# Autodesk Inventor assembly: ASSEMBLY_DUT_Ant_Rotator_REVB
(part 2 of 5)
199. COTS_BOSSARD_1400444_M6_Nylon_Nut:62 — Mate:495, Mate:498, Angle:62
200. COTS_BOSSARD_1400444_M6_Nylon_Nut:61 — Mate:494, Mate:499, Angle:61
201. COTS_BOSSARD_1400444_M6_Nylon_Nut:60 — Mate:496, Mate:497, Angle:63
202. COTS_DREMEC_8G206M6X50_M6x50_Nylon_Screw:62 — Mate:488, Mate:493, Mate:497
203. COTS_DREMEC_8G206M6X50_M6x50_Nylon_Screw:61 — Mate:489, Mate:491, Mate:499
204. COTS_DREMEC_8G206M6X50_M6x50_Nylon_Screw:60 — Mate:490, Mate:492, Mate:498
205. COTS_BOSSARD_1400444_M6_Nylon_Nut:59 — Mate:477, Mate:479, Angle:60
206. COTS_BOSSARD_1400444_M6_Nylon_Nut:58 — Mate:478, Mate:480, Angle:59
207. COTS_BOSSARD_1400444_M6_Nylon_Nut:57 — Mate:476, Mate:484, Angle:58
208. COTS_BOSSARD_1400444_M6_Nylon_Nut:56 — Mate:475, Mate:483, Angle:57
209. COTS_BOSSARD_1400444_M6_Nylon_Nut:55 — Mate:473, Mate:481, Angle:55
210. COTS_BOSSARD_1400444_M6_Nylon_Nut:54 — Mate:474, Mate:482, Angle:56
211. COTS_DREMEC_8G206M6X50_M6x50_Nylon_Screw:59 — Mate:465, Mate:470, Mate:484
212. COTS_DREMEC_8G206M6X50_M6x50_Nylon_Screw:58 — Mate:466, Mate:469, Mate:483
213. COTS_DREMEC_8G206M6X50_M6x50_Nylon_Screw:57 — Mate:464, Mate:471, Mate:480
214. COTS_DREMEC_8G206M6X50_M6x50_Nylon_Screw:56 — Mate:463, Mate:468, Mate:482
215. COTS_DREMEC_8G206M6X50_M6x50_Nylon_Screw:55 — Mate:461, Mate:472, Mate:479
216. COTS_DREMEC_8G206M6X50_M6x50_Nylon_Screw:54 — Mate:462, Mate:467, Mate:481
217. COTS_BOSSARD_1400444_M6_Nylon_Nut:53 — Mate:439, Mate:459, Angle:45
218. COTS_BOSSARD_1400444_M6_Nylon_Nut:52 — Mate:440, Mate:457, Angle:46
219. COTS_BOSSARD_1400444_M6_Nylon_Nut:51 — Mate:445, Mate:450
220. COTS_BOSSARD_1400444_M6_Nylon_Nut:50 — Mate:438, Mate:454, Angle:48
221. COTS_BOSSARD_1400444_M6_Nylon_Nut:49 — Mate:441, Mate:455, Angle:49
222. COTS_BOSSARD_1400444_M6_Nylon_Nut:48 — Mate:447, Mate:448, Angle:51
223. COTS_BOSSARD_1400444_M6_Nylon_Nut:47 — Mate:437, Mate:456, Angle:47
224. COTS_BOSSARD_1400444_M6_Nylon_Nut:46 — Mate:442, Mate:451
225. COTS_BOSSARD_1400444_M6_Nylon_Nut:45 — Mate:446, Mate:449, Angle:53
226. COTS_BOSSARD_1400444_M6_Nylon_Nut:44 — Mate:436, Mate:458, Angle:44
227. COTS_BOSSARD_1400444_M6_Nylon_Nut:43 — Mate:443, Mate:452, Angle:52
228. COTS_BOSSARD_1400444_M6_Nylon_Nut:42 — Mate:444, Mate:453, Angle:50
229. COTS_DREMEC_8G206M6X50_M6x50_Nylon_Screw:53 — Mate:423, Mate:426, Mate:456
230. COTS_DREMEC_8G206M6X50_M6x50_Nylon_Screw:52 — Mate:422, Mate:424, Mate:454
231. COTS_DREMEC_8G206M6X50_M6x50_Nylon_Screw:51 — Mate:421, Mate:429, Mate:459
232. COTS_DREMEC_8G206M6X50_M6x50_Nylon_Screw:50 — Mate:420, Mate:425, Mate:455
233. COTS_DREMEC_8G206M6X50_M6x50_Nylon_Screw:49 — Mate:419, Mate:427, Mate:457
234. COTS_DREMEC_8G206M6X50_M6x50_Nylon_Screw:48 — Mate:418, Mate:428, Mate:458
235. COTS_DREMEC_8G206M6X50_M6x50_Nylon_Screw:47 — Mate:417, Mate:434, Mate:449
236. COTS_DREMEC_8G206M6X50_M6x50_Nylon_Screw:46 — Mate:416, Mate:433, Mate:451
237. COTS_DREMEC_8G206M6X50_M6x50_Nylon_Screw:45 — Mate:415, Mate:435, Mate:452
238. COTS_DREMEC_8G206M6X50_M6x50_Nylon_Screw:44 — Mate:412, Mate:432, Mate:450
239. COTS_DREMEC_8G206M6X50_M6x50_Nylon_Screw:43 — Mate:413, Mate:430, Mate:448
240. COTS_DREMEC_8G206M6X50_M6x50_Nylon_Screw:42 — Mate:414, Mate:431, Mate:453
241. COTS_BOSSARD_1400428_M4_Nylon_Nut:2 — Mate:400, Mate:402
242. COTS_BOSSARD_1400428_M4_Nylon_Nut:1 — Mate:399, Mate:401
243. COTS_BOSSARD_1400444_M6_Nylon_Nut:30 — Mate:386, Mate:392
244. COTS_BOSSARD_1400444_M6_Nylon_Nut:29 — Mate:385, Mate:393
245. COTS_BOSSARD_1400444_M6_Nylon_Nut:28 — Mate:387, Mate:390
246. COTS_BOSSARD_1400444_M6_Nylon_Nut:27 — Mate:384, Mate:391
247. COTS_BOSSARD_1400444_M6_Nylon_Nut:26 — Mate:388, Mate:394
248. COTS_BOSSARD_1400444_M6_Nylon_Nut:25 — Mate:383, Mate:389
249. COTS_DREMEC_8G206M6X50_M6x50_Nylon_Screw:30 — Mate:376, Mate:379, Mate:392
250. COTS_DREMEC_8G206M6X50_M6x50_Nylon_Screw:29 — Mate:375, Mate:382, Mate:394
251. COTS_DREMEC_8G206M6X50_M6x50_Nylon_Screw:28 — Mate:374, Mate:378, Mate:389
252. COTS_DREMEC_8G206M6X50_M6x50_Nylon_Screw:27 — Mate:373, Mate:380, Mate:391
253. COTS_DREMEC_8G206M6X50_M6x50_Nylon_Screw:26 — Mate:372, Mate:377, Mate:390
254. COTS_DREMEC_8G206M6X50_M6x50_Nylon_Screw:25 — Mate:371, Mate:381, Mate:393
255. COTS_DREMEC_8G206V50126_M4x40_Screw:2 — Mate:368, Mate:369, Mate:402
256. COTS_DREMEC_8G206V50126_M4x40_Screw:1 — Mate:367, Mate:370, Mate:401
257. ISO 7380-1 M3 x 16:8 — Insert:8
258. ISO 7380-1 M3 x 16:7 — Insert:7
259. ISO 7380-1 M3 x 16:6 — Insert:6
260. DIN 125-1 A A 3,2:8 — Mate:347, Mate:348, Insert:8
261. DIN 125-1 A A 3,2:7 — Mate:345, Mate:346, Insert:7
262. DIN 125-1 A A 3,2:6 — Mate:343, Mate:344, Insert:6
263. ISO 7380-1 M3 x 16:5 — Insert:5
264. DIN 125-1 A A 3,2:5 — Mate:341, Mate:342, Insert:5
265. COTS_BOSSARD_1400444_M6_Nylon_Nut:24 — Mate:317, Mate:328
266. COTS_BOSSARD_1400444_M6_Nylon_Nut:23 — Mate:316, Mate:329
267. COTS_BOSSARD_1400444_M6_Nylon_Nut:22 — Mate:315, Mate:326
268. COTS_BOSSARD_1400444_M6_Nylon_Nut:21 — Mate:314, Mate:327
269. COTS_BOSSARD_1400444_M6_Nylon_Nut:20 — Mate:313, Mate:325
270. COTS_BOSSARD_1400444_M6_Nylon_Nut:19 — Mate:312, Mate:324
271. COTS_BOSSARD_1400444_M6_Nylon_Nut:18 — Mate:308, Mate:321
272. COTS_BOSSARD_1400444_M6_Nylon_Nut:17 — Mate:310, Mate:322
273. COTS_BOSSARD_1400444_M6_Nylon_Nut:16 — Mate:309, Mate:323
274. COTS_BOSSARD_1400444_M6_Nylon_Nut:15 — Mate:311, Mate:320
275. COTS_BOSSARD_1400444_M6_Nylon_Nut:14 — Mate:307, Mate:318
276. COTS_BOSSARD_1400444_M6_Nylon_Nut:13 — Mate:306, Mate:319
277. COTS_DREMEC_8G206M6X50_M6x50_Nylon_Screw:24 — Mate:293, Mate:299, Mate:324
278. COTS_DREMEC_8G206M6X50_M6x50_Nylon_Screw:23 — Mate:292, Mate:297, Mate:327
279. COTS_DREMEC_8G206M6X50_M6x50_Nylon_Screw:22 — Mate:290, Mate:294, Mate:329
280. COTS_DREMEC_8G206M6X50_M6x50_Nylon_Screw:21 — Mate:291, Mate:298, Mate:328
281. COTS_DREMEC_8G206M6X50_M6x50_Nylon_Screw:20 — Mate:289, Mate:295, Mate:326
282. COTS_DREMEC_8G206M6X50_M6x50_Nylon_Screw:19 — Mate:288, Mate:296, Mate:325
283. COTS_DREMEC_8G206M6X50_M6x50_Nylon_Screw:18 — Mate:287, Mate:301, Mate:320
284. COTS_DREMEC_8G206M6X50_M6x50_Nylon_Screw:17 — Mate:286, Mate:300, Mate:318
285. COTS_DREMEC_8G206M6X50_M6x50_Nylon_Screw:16 — Mate:283, Mate:302, Mate:321
286. COTS_DREMEC_8G206M6X50_M6x50_Nylon_Screw:15 — Mate:284, Mate:305, Mate:319
287. COTS_DREMEC_8G206M6X50_M6x50_Nylon_Screw:14 — Mate:285, Mate:303, Mate:322
288. COTS_DREMEC_8G206M6X50_M6x50_Nylon_Screw:13 — Mate:282, Mate:304, Mate:323
289. COTS_BOSSARD_1400444_M6_Nylon_Nut:12 — Mate:270, Mate:280
290. COTS_BOSSARD_1400444_M6_Nylon_Nut:11 — Mate:271, Mate:281
291. COTS_BOSSARD_1400444_M6_Nylon_Nut:10 — Mate:272, Mate:278
292. COTS_BOSSARD_1400444_M6_Nylon_Nut:9 — Mate:273, Mate:279
293. COTS_BOSSARD_1400444_M6_Nylon_Nut:8 — Mate:275, Mate:276
294. COTS_BOSSARD_1400444_M6_Nylon_Nut:7 — Mate:274, Mate:277
295. COTS_DREMEC_8G206M6X50_M6x50_Nylon_Screw:12 — Mate:263, Mate:268, Mate:278
296. COTS_DREMEC_8G206M6X50_M6x50_Nylon_Screw:11 — Mate:262, Mate:265, Mate:279
297. COTS_DREMEC_8G206M6X50_M6x50_Nylon_Screw:10 — Mate:261, Mate:269, Mate:280
298. COTS_DREMEC_8G206M6X50_M6x50_Nylon_Screw:9 — Mate:260, Mate:264, Mate:281
299. COTS_DREMEC_8G206M6X50_M6x50_Nylon_Screw:8 — Mate:259, Mate:266, Mate:276
300. COTS_DREMEC_8G206M6X50_M6x50_Nylon_Screw:7 — Mate:258, Mate:267, Mate:277
301. COTS_BOSSARD_1400444_M6_Nylon_Nut:6 — Mate:233, Mate:239
302. COTS_BOSSARD_1400444_M6_Nylon_Nut:5 — Mate:230, Mate:237
303. COTS_BOSSARD_1400444_M6_Nylon_Nut:4 — Mate:231, Mate:236
304. COTS_BOSSARD_1400444_M6_Nylon_Nut:3 — Mate:232, Mate:238
305. COTS_BOSSARD_1400444_M6_Nylon_Nut:2 — Mate:229, Mate:235
306. COTS_BOSSARD_1400444_M6_Nylon_Nut:1 — Mate:228, Mate:234
307. COTS_DREMEC_8G206M6X50_M6x50_Nylon_Screw:6 — Mate:221, Mate:227, Mate:239
308. COTS_DREMEC_8G206M6X50_M6x50_Nylon_Screw:5 — Mate:220, Mate:226, Mate:238
309. COTS_DREMEC_8G206M6X50_M6x50_Nylon_Screw:4 — Mate:219, Mate:225, Mate:236
310. COTS_DREMEC_8G206M6X50_M6x50_Nylon_Screw:3 — Mate:216, Mate:223, Mate:234
311. COTS_DREMEC_8G206M6X50_M6x50_Nylon_Screw:2 — Mate:218, Mate:224, Mate:237
312. COTS_DREMEC_8G206M6X50_M6x50_Nylon_Screw:1 — Mate:217, Mate:222, Mate:235
313. DIN 934 - replaced by DIN EN 24032/28673/28674 M4:21 — Mate:207, Mate:208, Angle:37
314. DIN 934 - replaced by DIN EN 24032/28673/28674 M4:20 — Mate:205, Mate:206, Angle:38
315. DIN 934 - replaced by DIN EN 24032/28673/28674 M4:19 — Mate:203, Mate:204, Angle:39
316. DIN 934 - replaced by DIN EN 24032/28673/28674 M4:18 — Mate:201, Mate:202, Angle:40
317. DIN 934 - replaced by DIN EN 24032/28673/28674 M4:17 — Mate:199, Mate:200, Angle:33
318. DIN 934 - replaced by DIN EN 24032/28673/28674 M4:16 — Mate:197, Mate:198, Angle:36
319. DIN 934 - replaced by DIN EN 24032/28673/28674 M4:15 — Mate:195, Mate:196, Angle:34
320. DIN 912 - replaced by DIN EN ISO 4762 M4 x 20:8 — Mate:191, Mate:192
321. DIN 912 - replaced by DIN EN ISO 4762 M4 x 20:7 — Mate:189, Mate:190
322. DIN 912 - replaced by DIN EN ISO 4762 M4 x 20:6 — Mate:187, Mate:188
323. DIN 912 - replaced by DIN EN ISO 4762 M4 x 20:5 — Mate:185, Mate:186
324. DIN 912 - replaced by DIN EN ISO 4762 M4 x 20:4 — Mate:183, Mate:184
325. DIN 912 - replaced by DIN EN ISO 4762 M4 x 20:3 — Mate:181, Mate:182
326. DIN 912 - replaced by DIN EN ISO 4762 M4 x 20:2 — Mate:179, Mate:180
327. DIN 934 - replaced by DIN EN 24032/28673/28674 M4:14 — Mate:193, Mate:194, Angle:35
328. DIN 912 - replaced by DIN EN ISO 4762 M4 x 20:1 — Mate:177, Mate:178
329. DIN 934 - replaced by DIN EN 24032/28673/28674 M5:20 — Mate:175, Mate:176, Angle:27
330. DIN 934 - replaced by DIN EN 24032/28673/28674 M5:19 — Mate:173, Mate:174, Angle:28
331. DIN 934 - replaced by DIN EN 24032/28673/28674 M5:18 — Mate:171, Mate:172, Angle:29
332. DIN 934 - replaced by DIN EN 24032/28673/28674 M5:17 — Mate:169, Mate:170, Angle:30
333. DIN 934 - replaced by DIN EN 24032/28673/28674 M5:16 — Mate:167, Mate:168, Angle:31
334. DIN 934 - replaced by DIN EN 24032/28673/28674 M5:15 — Mate:165, Mate:166, Angle:32
335. DIN 934 - replaced by DIN EN 24032/28673/28674 M5:14 — Mate:163, Mate:164, Angle:24
336. DIN 934 - replaced by DIN EN 24032/28673/28674 M5:13 — Mate:161, Mate:162, Angle:23
337. DIN 934 - replaced by DIN EN 24032/28673/28674 M5:12 — Mate:159, Mate:160, Angle:22
338. DIN 934 - replaced by DIN EN 24032/28673/28674 M5:11 — Mate:157, Mate:158, Angle:25
339. DIN 934 - replaced by DIN EN 24032/28673/28674 M5:10 — Mate:155, Mate:156, Angle:26
340. DIN 912 - replaced by DIN EN ISO 4762 M5 x 50:20 — Mate:151, Mate:152
341. DIN 912 - replaced by DIN EN ISO 4762 M5 x 50:19 — Mate:149, Mate:150
342. DIN 912 - replaced by DIN EN ISO 4762 M5 x 50:18 — Mate:147, Mate:148
343. DIN 912 - replaced by DIN EN ISO 4762 M5 x 50:17 — Mate:145, Mate:146
344. DIN 912 - replaced by DIN EN ISO 4762 M5 x 50:16 — Mate:143, Mate:144
345. DIN 912 - replaced by DIN EN ISO 4762 M5 x 50:15 — Mate:141, Mate:142
346. DIN 912 - replaced by DIN EN ISO 4762 M5 x 50:14 — Mate:139, Mate:140
347. DIN 912 - replaced by DIN EN ISO 4762 M5 x 50:13 — Mate:137, Mate:138
348. DIN 912 - replaced by DIN EN ISO 4762 M5 x 50:12 — Mate:135, Mate:136
349. DIN 912 - replaced by DIN EN ISO 4762 M5 x 50:11 — Mate:133, Mate:134
350. DIN 912 - replaced by DIN EN ISO 4762 M5 x 50:10 — Mate:131, Mate:132
351. DIN 934 - replaced by DIN EN 24032/28673/28674 M5:9 — Mate:153, Mate:154, Angle:21
352. DIN 912 - replaced by DIN EN ISO 4762 M5 x 50:9 — Mate:129, Mate:130
353. DIN 934 - replaced by DIN EN 24032/28673/28674 M4:11 — Mate:93, Mate:94, Angle:20
354. DIN 934 - replaced by DIN EN 24032/28673/28674 M4:10 — Mate:91, Mate:92, Angle:19
355. ISO 7380-1 M4 x 40:11 — Mate:87, Mate:88
356. ISO 7380-1 M4 x 40:10 — Mate:85, Mate:86
357. DIN 934 - replaced by DIN EN 24032/28673/28674 M4:9 — Mate:89, Mate:90, Angle:18
358. ISO 7380-1 M4 x 40:9 — Mate:83, Mate:84
359. ISO 7380-1 M3 x 16:4 — Insert:4
360. ISO 7380-1 M3 x 16:3 — Insert:3
361. ISO 7380-1 M3 x 16:2 — Insert:2
362. DIN 125-1 A A 3,2:4 — Mate:116, Mate:117, Insert:4
363. DIN 125-1 A A 3,2:3 — Mate:114, Mate:115, Insert:3
364. DIN 125-1 A A 3,2:2 — Mate:112, Mate:113, Insert:2
365. ISO 7380-1 M3 x 16:1 — Insert:1
366. DIN 125-1 A A 3,2:1 — Mate:110, Mate:111, Insert:1
367. DIN 934 - replaced by DIN EN 24032/28673/28674 M5:8 — Mate:75, Mate:76, Angle:15
368. DIN 934 - replaced by DIN EN 24032/28673/28674 M5:7 — Mate:73, Mate:74, Angle:14
369. DIN 934 - replaced by DIN EN 24032/28673/28674 M5:6 — Mate:71, Mate:72, Angle:13
370. DIN 934 - replaced by DIN EN 24032/28673/28674 M5:5 — Mate:69, Mate:70, Angle:12
371. DIN 934 - replaced by DIN EN 24032/28673/28674 M5:4 — Mate:67, Mate:68, Angle:11
372. DIN 934 - replaced by DIN EN 24032/28673/28674 M5:3 — Mate:65, Mate:66, Angle:10
373. DIN 934 - replaced by DIN EN 24032/28673/28674 M5:2 — Mate:63, Mate:64, Angle:9
374. DIN 912 - replaced by DIN EN ISO 4762 M5 x 50:8 — Mate:59, Mate:60
375. DIN 912 - replaced by DIN EN ISO 4762 M5 x 50:7 — Mate:57, Mate:58
376. DIN 912 - replaced by DIN EN ISO 4762 M5 x 50:6 — Mate:55, Mate:56
377. DIN 912 - replaced by DIN EN ISO 4762 M5 x 50:5 — Mate:53, Mate:54
378. DIN 912 - replaced by DIN EN ISO 4762 M5 x 50:4 — Mate:51, Mate:52
379. DIN 912 - replaced by DIN EN ISO 4762 M5 x 50:3 — Mate:49, Mate:50
380. DIN 912 - replaced by DIN EN ISO 4762 M5 x 50:2 — Mate:47, Mate:48
381. DIN 934 - replaced by DIN EN 24032/28673/28674 M5:1 — Mate:61, Mate:62, Angle:16
382. DIN 912 - replaced by DIN EN ISO 4762 M5 x 50:1 — Mate:45, Mate:46
383. ISO 7380-1 M4 x 40:1 — Mate:8, Mate:9
384. DIN 934 - replaced by DIN EN 24032/28673/28674 M4:1 — Mate:24, Mate:25, Angle:8
385. ISO 7380-1 M4 x 40:2 — Mate:10, Mate:11
386. ISO 7380-1 M4 x 40:3 — Mate:12, Mate:13
387. ISO 7380-1 M4 x 40:4 — Mate:14, Mate:15
388. ISO 7380-1 M4 x 40:5 — Mate:16, Mate:17
389. ISO 7380-1 M4 x 40:6 — Mate:18, Mate:19
390. ISO 7380-1 M4 x 40:7 — Mate:20, Mate:21
391. ISO 7380-1 M4 x 40:8 — Mate:22, Mate:23
392. DIN 934 - replaced by DIN EN 24032/28673/28674 M4:2 — Mate:26, Mate:27, Angle:1
393. DIN 934 - replaced by DIN EN 24032/28673/28674 M4:3 — Mate:28, Mate:29, Angle:2
394. DIN 934 - replaced by DIN EN 24032/28673/28674 M4:4 — Mate:30, Mate:31, Angle:3
395. DIN 934 - replaced by DIN EN 24032/28673/28674 M4:5 — Mate:32, Mate:33, Angle:4
396. DIN 934 - replaced by DIN EN 24032/28673/28674 M4:6 — Mate:34, Mate:35, Angle:5
397. DIN 934 - replaced by DIN EN 24032/28673/28674 M4:7 — Mate:36, Mate:37, Angle:6
398. DIN 934 - replaced by DIN EN 24032/28673/28674 M4:8 — Mate:38, Mate:39, Angle:7
399. COTS_Fleximo_FB12020_20x20_Alu_Profile_575mm:1 — Mate:640, Flush:35, Flush:36, Mate:641, Flush:37, Flush:38, Mate:642, Flush:39, Flush:40, Mate:643, Flush:41, Mate:649, Mate:650, Angle:67, Angle:68, Mate:904, Flush:58
400. 3DP_PLA_Foldable_Leg_Brace_Mount_REVB:1 — Mate:643, Flush:41, Mate:644, Mate:647, Mate:648, Mate:651, Mate:652, Mate:657, Mate:658, Mate:659, Mate:660, Flush:59
401. COTS_GENERIC_5mm_Carbon_Rod:1 — Mate:647, Mate:648
402. COTS_Fleximo_FB12020_20x20_Alu_Profile_600mm:1 — Mate:632, Flush:25, Flush:26, Mate:633, Flush:27, Flush:28, Mate:634, Flush:29, Mate:637, Flush:30, Mate:639, Flush:33, Flush:34, Mate:645, Flush:42, Mate:653, Mate:654, Angle:69, Angle:70, Mate:855, Flush:46, Mate:877, Flush:48, Mate:890, Flush:54, Flush:55, Mate:897, Flush:56, Flush:57
403. COTS_Fleximo_FBP2020_20x20_Hinge:1 — Mate:639, Flush:33, Flush:34, Mate:640, Flush:35, Flush:36
404. COTS_Fleximo_FB1K2020_Angle:1 — Mate:634, Mate:635, Flush:29
405. COTS_Fleximo_FB12020_20x20_Alu_Profile_150mm:2 — Mate:633, Flush:27, Flush:28, Mate:635, Mate:770, Mate:771, Mate:772, Mate:773, Mate:774, Angle:72, Angle:73
406. DIN 125-1 A A 4,3:5 — Mate:777, Mate:778, Insert:28
407. DIN 912 - replaced by DIN EN ISO 4762 M4 x 16:1 — Insert:28
408. DIN 912 - replaced by DIN EN ISO 4762 M4 x 16:2 — Insert:29
409. DIN 125-1 A A 4,3:6 — Mate:779, Mate:780, Insert:29
410. COTS_Fleximo_FB1K2020_Angle:2 — Mate:636, Mate:637, Flush:30
411. 3DP_PLA_Foldable_Leg_Brace_Mount_REVB:2 — Mate:645, Flush:42, Mate:655, Mate:656, Mate:661, Mate:662, Mate:663, Mate:664
412. ISO 7380-1 M3 x 12:4 — Mate:663, Mate:664
413. ISO 7380-1 M3 x 12:3 — Mate:661, Mate:662
414. COTS_Fleximo_FB12020_20x20_Alu_Profile_150mm:1 — Mate:629, Mate:630, Mate:632, Flush:25, Flush:26, Mate:636, Mate:690, Mate:691, Mate:729, Angle:71, Mate:731, Mate:856, Flush:49
415. DIN 912 - replaced by DIN EN ISO 4762 M4 x 10:1 — Insert:27
416. DIN 125-1 A A 4,3:4 — Mate:768, Mate:769, Insert:27
417. ISO 7380-1 M3 x 12:1 — Mate:657, Mate:658
418. ISO 7380-1 M3 x 12:2 — Mate:659, Mate:660
419. COTS_Fleximo_FB1ZP20C_20x20_End_Cap:3 — Mate:642, Flush:39, Flush:40, Mate:644
420. COTS_Fleximo_FB1NM3_M3_Nut_20x20:4 — Mate:650, Angle:67, Mate:651
421. COTS_Fleximo_FB1NM3_M3_Nut_20x20:3 — Mate:653, Angle:70, Mate:656
422. COTS_Fleximo_FB1NM3_M3_Nut_20x20:2 — Mate:654, Angle:69, Mate:655
423. COTS_Fleximo_FB1NM3_M3_Nut_20x20:1 — Mate:649, Angle:68, Mate:652
424. COTS_Fleximo_FB1NM4_M4_Nut_20x20:1 — Mate:729, Angle:71, Mate:730
425. COTS_Fleximo_FB1NM4_M4_Nut_20x20:3 — Mate:774, Angle:73, Mate:776
426. COTS_Fleximo_FB1NM4_M4_Nut_20x20:2 — Mate:773, Angle:72, Mate:775
427. COTS_Fleximo_FB1ZP20C_20x20_End_Cap:2 — Mate:641, Flush:37, Flush:38
428. COTS_Fleximo_FB12020_20x20_Alu_Profile_575mm:2
429. 3DP_PLA_Foldable_Leg_Brace_Mount_REVB:3
430. COTS_GENERIC_5mm_Carbon_Rod:2
431. COTS_Fleximo_FB12020_20x20_Alu_Profile_600mm:2 — Mate:818, Mate:819, Mate:820, Mate:821, Mate:822, Mate:824, Mate:825, Mate:826, Mate:857, Flush:47, Mate:915, Mate:916
432. COTS_Fleximo_FBP2020_20x20_Hinge:2
433. COTS_Fleximo_FB1K2020_Angle:3
434. COTS_Fleximo_FB12020_20x20_Alu_Profile_150mm:3 — Mate:830, Mate:858
435. DIN 125-1 A A 4,3:7
436. DIN 912 - replaced by DIN EN ISO 4762 M4 x 16:3
437. DIN 912 - replaced by DIN EN ISO 4762 M4 x 16:4
438. DIN 125-1 A A 4,3:8
439. COTS_Fleximo_FB1K2020_Angle:4
440. 3DP_PLA_Foldable_Leg_Brace_Mount_REVB:4
441. ISO 7380-1 M3 x 12:5
442. ISO 7380-1 M3 x 12:6
443. COTS_Fleximo_FB12020_20x20_Alu_Profile_150mm:4
444. DIN 912 - replaced by DIN EN ISO 4762 M4 x 10:2
445. DIN 125-1 A A 4,3:9
446. ISO 7380-1 M3 x 12:7
447. ISO 7380-1 M3 x 12:8
448. COTS_Fleximo_FB1ZP20C_20x20_End_Cap:5
449. COTS_Fleximo_FB1NM3_M3_Nut_20x20:5
450. COTS_Fleximo_FB1NM3_M3_Nut_20x20:6
451. COTS_Fleximo_FB1NM3_M3_Nut_20x20:7
452. COTS_Fleximo_FB1NM3_M3_Nut_20x20:8
453. COTS_Fleximo_FB1NM4_M4_Nut_20x20:4
454. COTS_Fleximo_FB1NM4_M4_Nut_20x20:5
455. COTS_Fleximo_FB1NM4_M4_Nut_20x20:6
456. COTS_Fleximo_FB1ZP20C_20x20_End_Cap:8
457. COTS_Fleximo_FB12020_20x20_Alu_Profile_575mm:3
458. 3DP_PLA_Foldable_Leg_Brace_Mount_REVB:5
459. COTS_GENERIC_5mm_Carbon_Rod:3
460. COTS_Fleximo_FB12020_20x20_Alu_Profile_600mm:3 — Flush:51, Flush:53
461. COTS_Fleximo_FBP2020_20x20_Hinge:3
462. COTS_Fleximo_FB1K2020_Angle:5
463. COTS_Fleximo_FB12020_20x20_Alu_Profile_150mm:5 — Mate:880, Flush:50
464. DIN 125-1 A A 4,3:10
465. DIN 912 - replaced by DIN EN ISO 4762 M4 x 16:5
466. DIN 912 - replaced by DIN EN ISO 4762 M4 x 16:6
467. DIN 125-1 A A 4,3:11
468. COTS_Fleximo_FB1K2020_Angle:6
469. 3DP_PLA_Foldable_Leg_Brace_Mount_REVB:6
470. ISO 7380-1 M3 x 12:9
471. ISO 7380-1 M3 x 12:10
472. COTS_Fleximo_FB12020_20x20_Alu_Profile_150mm:6 — Mate:881, Flush:52
473. DIN 912 - replaced by DIN EN ISO 4762 M4 x 10:3
474. DIN 125-1 A A 4,3:12
475. ISO 7380-1 M3 x 12:11
476. ISO 7380-1 M3 x 12:12
477. COTS_Fleximo_FB1ZP20C_20x20_End_Cap:7
478. COTS_Fleximo_FB1NM3_M3_Nut_20x20:9
479. COTS_Fleximo_FB1NM3_M3_Nut_20x20:10
480. COTS_Fleximo_FB1NM3_M3_Nut_20x20:11
481. COTS_Fleximo_FB1NM3_M3_Nut_20x20:12
482. COTS_Fleximo_FB1NM4_M4_Nut_20x20:7
483. COTS_Fleximo_FB1NM4_M4_Nut_20x20:8
484. COTS_Fleximo_FB1NM4_M4_Nut_20x20:9
485. COTS_Fleximo_FB1ZP20C_20x20_End_Cap:9
486. 3DP_PLA_Alu_Frame_Brace_REVB:1 — Mate:855, Flush:46, Mate:856, Mate:860, Mate:865, Mate:866, Mate:867, Mate:868, Mate:874, Mate:876
487. 3DP_PLA_Alu_Frame_Brace_REVB:2 — Mate:857, Flush:47, Mate:858, Mate:859, Angle:74, Mate:861, Mate:862, Mate:863, Mate:864
488. LC_3mm_ALU_Alu_Frame_Brace_REVB:1 — Mate:859, Mate:860, Angle:74, Mate:869, Mate:870, Mate:871, Mate:872, Mate:873, Mate:875
489. DIN 125-1 A A 4,3:21 — Mate:861, Mate:862, Insert:44
490. DIN 912 - replaced by DIN EN ISO 4762 M4 x 10:8 — Insert:44
491. DIN 125-1 A A 4,3:22 — Mate:863, Mate:864, Insert:45
492. DIN 912 - replaced by DIN EN ISO 4762 M4 x 10:9 — Insert:45
493. DIN 125-1 A A 4,3:23 — Mate:865, Mate:866, Insert:46
494. DIN 912 - replaced by DIN EN ISO 4762 M4 x 10:10 — Insert:46
495. DIN 125-1 A A 4,3:24 — Mate:867, Mate:868, Insert:47
496. DIN 912 - replaced by DIN EN ISO 4762 M4 x 10:11 — Insert:47
497. DIN 125-1 A A 4,3:25 — Mate:869, Mate:870, Insert:48
498. DIN 912 - replaced by DIN EN ISO 4762 M4 x 25:1 — Insert:48
499. DIN 934 - replaced by DIN EN 24032/28673/28674 M4:33 — Mate:873, Mate:874
500. DIN 125-1 A A 4,3:26 — Mate:871, Mate:872, Insert:49
501. DIN 912 - replaced by DIN EN ISO 4762 M4 x 25:2 — Insert:49
502. DIN 934 - replaced by DIN EN 24032/28673/28674 M4:34 — Mate:875, Mate:876
503. 3DP_PLA_Alu_Frame_Brace_REVB:3
504. 3DP_PLA_Alu_Frame_Brace_REVB:4
505. LC_3mm_ALU_Alu_Frame_Brace_REVB:2
506. DIN 125-1 A A 4,3:27
507. DIN 912 - replaced by DIN EN ISO 4762 M4 x 10:12
508. DIN 125-1 A A 4,3:28
509. DIN 912 - replaced by DIN EN ISO 4762 M4 x 10:13
510. DIN 125-1 A A 4,3:29
511. DIN 912 - replaced by DIN EN ISO 4762 M4 x 10:14
512. DIN 125-1 A A 4,3:30
513. DIN 912 - replaced by DIN EN ISO 4762 M4 x 10:15
514. DIN 125-1 A A 4,3:31
515. DIN 912 - replaced by DIN EN ISO 4762 M4 x 25:3
516. DIN 934 - replaced by DIN EN 24032/28673/28674 M4:35
517. DIN 125-1 A A 4,3:32
518. DIN 912 - replaced by DIN EN ISO 4762 M4 x 25:4
519. DIN 934 - replaced by DIN EN 24032/28673/28674 M4:36
520. 3DP_PLA_Alu_Frame_Brace_REVB:5
521. 3DP_PLA_Alu_Frame_Brace_REVB:6
522. LC_3mm_ALU_Alu_Frame_Brace_REVB:3
523. DIN 125-1 A A 4,3:33
524. DIN 912 - replaced by DIN EN ISO 4762 M4 x 10:16
525. DIN 125-1 A A 4,3:34
526. DIN 912 - replaced by DIN EN ISO 4762 M4 x 10:17
527. DIN 125-1 A A 4,3:35
528. DIN 912 - replaced by DIN EN ISO 4762 M4 x 10:18
529. DIN 125-1 A A 4,3:36
530. DIN 912 - replaced by DIN EN ISO 4762 M4 x 10:19
531. DIN 125-1 A A 4,3:37
532. DIN 912 - replaced by DIN EN ISO 4762 M4 x 25:5
533. DIN 934 - replaced by DIN EN 24032/28673/28674 M4:37
534. DIN 125-1 A A 4,3:38
535. DIN 912 - replaced by DIN EN ISO 4762 M4 x 25:6
536. DIN 934 - replaced by DIN EN 24032/28673/28674 M4:38
537. 3DP_PLA_Folded_Leg_Holder_REVB:1 — Mate:877, Flush:48, Flush:49, Mate:878, Mate:879
538. DIN 912 - replaced by DIN EN ISO 4762 M4 x 16:7 — Mate:878, Mate:879
539. 3DP_PLA_Folded_Leg_Holder_REVB:2
540. DIN 912 - replaced by DIN EN ISO 4762 M4 x 16:8
541. 3DP_PLA_Folded_Leg_Holder_REVB:3 — Flush:60
542. DIN 912 - replaced by DIN EN ISO 4762 M4 x 16:9
543. ISO 7380-1 M6 x 16:1 — Mate:891, Mate:892
544. 3DP_PLA_Frame_Stiffener_and_Leg_REVB:1 — Mate:890, Flush:54, Flush:55, Mate:891, Mate:892, Mate:893, Mate:894, Mate:895, Mate:896
545. ISO 7380-1 M5 x 8:1 — Mate:893, Mate:894
546. ISO 7380-1 M5 x 8:2 — Mate:895, Mate:896
547. 3DP_PLA_Frame_Stiffener_and_Leg_REVB:2 — Mate:897, Flush:56, Flush:57, Mate:898, Mate:899, Mate:900, Mate:901, Mate:902, Mate:903
548. ISO 7380-1 M6 x 16:2 — Mate:898, Mate:899
549. ISO 7380-1 M5 x 8:3 — Mate:900, Mate:901
550. ISO 7380-1 M5 x 8:4 — Mate:902, Mate:903
551. ISO 7380-1 M6 x 16:3
552. 3DP_PLA_Frame_Stiffener_and_Leg_REVB:3
553. ISO 7380-1 M5 x 8:5
554. ISO 7380-1 M5 x 8:6
555. 3DP_PLA_Frame_Stiffener_and_Leg_REVB:4
556. ISO 7380-1 M6 x 16:4
557. ISO 7380-1 M5 x 8:7
558. ISO 7380-1 M5 x 8:8
559. ISO 7380-1 M6 x 16:5
560. 3DP_PLA_Frame_Stiffener_and_Leg_REVB:5
561. ISO 7380-1 M5 x 8:9
562. ISO 7380-1 M5 x 8:10
563. 3DP_PLA_Frame_Stiffener_and_Leg_REVB:6
564. ISO 7380-1 M6 x 16:6
565. ISO 7380-1 M5 x 8:11
566. ISO 7380-1 M5 x 8:12
567. ISO 7380-1 M5 x 8:13 — Mate:905, Mate:906
568. 3DP_PLA_Frame_Leg_Leg_REVB:1 — Mate:904, Flush:58, Flush:59, Mate:905, Mate:906, Mate:907, Mate:908
569. ISO 7380-1 M5 x 8:14 — Mate:907, Mate:908
570. ISO 7380-1 M5 x 8:15
571. 3DP_PLA_Frame_Leg_Leg_REVB:2
572. ISO 7380-1 M5 x 8:16
573. ISO 7380-1 M5 x 8:17
574. 3DP_PLA_Frame_Leg_Leg_REVB:3
575. ISO 7380-1 M5 x 8:18
576. COTS_BOSSARD_1400444_M6_Nylon_Nut:31 — Mate:397, Mate:398
577. COTS_DREMEC_8G206M6X50_M6x50_Nylon_Screw:31 — Mate:395, Mate:396, Mate:398
578. COTS_BOSSARD_1400444_M6_Nylon_Nut:32
579. COTS_DREMEC_8G206M6X50_M6x50_Nylon_Screw:32
580. COTS_BOSSARD_1400444_M6_Nylon_Nut:33
581. COTS_DREMEC_8G206M6X50_M6x50_Nylon_Screw:33
582. COTS_BOSSARD_1400444_M6_Nylon_Nut:34
583. COTS_DREMEC_8G206M6X50_M6x50_Nylon_Screw:34
584. COTS_BOSSARD_1400444_M6_Nylon_Nut:35
585. COTS_DREMEC_8G206M6X50_M6x50_Nylon_Screw:35
586. COTS_BOSSARD_1400444_M6_Nylon_Nut:36
587. COTS_DREMEC_8G206M6X50_M6x50_Nylon_Screw:36
588. COTS_BOSSARD_1400444_M6_Nylon_Nut:37
589. COTS_DREMEC_8G206M6X50_M6x50_Nylon_Screw:37
590. COTS_BOSSARD_1400444_M6_Nylon_Nut:38
591. COTS_DREMEC_8G206M6X50_M6x50_Nylon_Screw:38
592. COTS_BOSSARD_1400444_M6_Nylon_Nut:39
593. COTS_DREMEC_8G206M6X50_M6x50_Nylon_Screw:39
594. COTS_BOSSARD_1400444_M6_Nylon_Nut:40
595. COTS_DREMEC_8G206M6X50_M6x50_Nylon_Screw:40
596. COTS_BOSSARD_1400444_M6_Nylon_Nut:41
597. COTS_DREMEC_8G206M6X50_M6x50_Nylon_Screw:41
## Component patterns: (3 elements, first: COTS_Fleximo_FB12020_20x20_Alu_Profile_575mm:1 + 3DP_PLA_Foldable_Leg_Brace_Mount_REVB:1 + COTS_GENERIC_5mm_Carbon_Rod:1 + COTS_Fleximo_FB12020_20x20_Alu_Profile_600mm:1 + COTS_Fleximo_FBP2020_20x20_Hinge:1 + COTS_Fleximo_FB1K2020_Angle:1 + COTS_Fleximo_FB12020_20x20_Alu_Profile_150mm:2 + DIN 125-1 A A 4,3:5 + DIN 912 - replaced by DIN EN ISO 4762 M4 x 16:1 + DIN 912 - replaced by DIN EN ISO 4762 M4 x 16:2 + DIN 125-1 A A 4,3:6 + COTS_Fleximo_FB1K2020_Angle:2 + 3DP_PLA_Foldable_Leg_Brace_Mount_REVB:2 + ISO 7380-1 M3 x 12:4 + ISO 7380-1 M3 x 12:3 + COTS_Fleximo_FB12020_20x20_Alu_Profile_150mm:1 + DIN 912 - replaced by DIN EN ISO 4762 M4 x 10:1 + DIN 125-1 A A 4,3:4 + ISO 7380-1 M3 x 12:1 + ISO 7380-1 M3 x 12:2 + COTS_Fleximo_FB1ZP20C_20x20_End_Cap:3 + COTS_Fleximo_FB1NM3_M3_Nut_20x20:4 + COTS_Fleximo_FB1NM3_M3_Nut_20x20:3 + COTS_Fleximo_FB1NM3_M3_Nut_20x20:2 + COTS_Fleximo_FB1NM3_M3_Nut_20x20:1 + COTS_Fleximo_FB1NM4_M4_Nut_20x20:1 + COTS_Fleximo_FB1NM4_M4_Nut_20x20:3 + COTS_Fleximo_FB1NM4_M4_Nut_20x20:2 + COTS_Fleximo_FB1ZP20C_20x20_End_Cap:2), (3 elements, first: 3DP_PLA_Alu_Frame_Brace_REVB:1 + 3DP_PLA_Alu_Frame_Brace_REVB:2 + LC_3mm_ALU_Alu_Frame_Brace_REVB:1 + DIN 125-1 A A 4,3:21 + DIN 912 - replaced by DIN EN ISO 4762 M4 x 10:8 + DIN 125-1 A A 4,3:22 + DIN 912 - replaced by DIN EN ISO 4762 M4 x 10:9 + DIN 125-1 A A 4,3:23 + DIN 912 - replaced by DIN EN ISO 4762 M4 x 10:10 + DIN 125-1 A A 4,3:24 + DIN 912 - replaced by DIN EN ISO 4762 M4 x 10:11 + DIN 125-1 A A 4,3:25 + DIN 912 - replaced by DIN EN ISO 4762 M4 x 25:1 + DIN 934 - replaced by DIN EN 24032/28673/28674 M4:33 + DIN 125-1 A A 4,3:26 + DIN 912 - replaced by DIN EN ISO 4762 M4 x 25:2 + DIN 934 - replaced by DIN EN 24032/28673/28674 M4:34), (3 elements, first: 3DP_PLA_Folded_Leg_Holder_REVB:1 + DIN 912 - replaced by DIN EN ISO 4762 M4 x 16:7), (3 elements, first: ISO 7380-1 M6 x 16:1 + 3DP_PLA_Frame_Stiffener_and_Leg_REVB:1 + ISO 7380-1 M5 x 8:1 + ISO 7380-1 M5 x 8:2 + 3DP_PLA_Frame_Stiffener_and_Leg_REVB:2 + ISO 7380-1 M6 x 16:2 + ISO 7380-1 M5 x 8:3 + ISO 7380-1 M5 x 8:4), (3 elements, first: ISO 7380-1 M5 x 8:13 + 3DP_PLA_Frame_Leg_Leg_REVB:1 + ISO 7380-1 M5 x 8:14), (11 elements, first: COTS_BOSSARD_1400444_M6_Nylon_Nut:31 + COTS_DREMEC_8G206M6X50_M6x50_Nylon_Screw:31)
## Relationships (1012: Mate 818, Angle 75, Flush 72, Insert 47)
- Mate:1: 3DP_PLA_A_Axis_Bearing_Base:1
- Mate:2: 3DP_PLA_A_Axis_Bearing_Base:1
- Mate:3: COTS_GENERIC_6020_2RS_150x100x24mm_Ball_Bearing:1 ↔ 3DP_PLA_A_Axis_Bearing_Base:1
- Mate:4: COTS_GENERIC_6020_2RS_150x100x24mm_Ball_Bearing:1 ↔ 3DP_PLA_A_Axis_Bearing_Base:1
- Mate:5 (0.2 mm): 3DP_PLA_A_Axis_Bearing_Base:1 ↔ 3DP_PLA_A_Axis_Bearing_Base_Bearing_Locking_Ring:1
- Mate:6: 3DP_PLA_A_Axis_Bearing_Base:1 ↔ 3DP_PLA_A_Axis_Bearing_Base_Bearing_Locking_Ring:1
- Mate:7: 3DP_PLA_A_Axis_Bearing_Base:1 ↔ 3DP_PLA_A_Axis_Bearing_Base_Bearing_Locking_Ring:1
- Mate:8: 3DP_PLA_A_Axis_Bearing_Base_Bearing_Locking_Ring:1 ↔ ISO 7380-1 M4 x 40:1
- Mate:9: 3DP_PLA_A_Axis_Bearing_Base_Bearing_Locking_Ring:1 ↔ ISO 7380-1 M4 x 40:1
- Mate:10: 3DP_PLA_A_Axis_Bearing_Base_Bearing_Locking_Ring:1 ↔ ISO 7380-1 M4 x 40:2
- Mate:11: 3DP_PLA_A_Axis_Bearing_Base_Bearing_Locking_Ring:1 ↔ ISO 7380-1 M4 x 40:2
- Mate:12: 3DP_PLA_A_Axis_Bearing_Base_Bearing_Locking_Ring:1 ↔ ISO 7380-1 M4 x 40:3
- Mate:13: 3DP_PLA_A_Axis_Bearing_Base_Bearing_Locking_Ring:1 ↔ ISO 7380-1 M4 x 40:3
- Mate:14: 3DP_PLA_A_Axis_Bearing_Base_Bearing_Locking_Ring:1 ↔ ISO 7380-1 M4 x 40:4
- Mate:15: 3DP_PLA_A_Axis_Bearing_Base_Bearing_Locking_Ring:1 ↔ ISO 7380-1 M4 x 40:4
- Mate:16: 3DP_PLA_A_Axis_Bearing_Base_Bearing_Locking_Ring:1 ↔ ISO 7380-1 M4 x 40:5
- Mate:17: 3DP_PLA_A_Axis_Bearing_Base_Bearing_Locking_Ring:1 ↔ ISO 7380-1 M4 x 40:5
- Mate:18: 3DP_PLA_A_Axis_Bearing_Base_Bearing_Locking_Ring:1 ↔ ISO 7380-1 M4 x 40:6
- Mate:19: 3DP_PLA_A_Axis_Bearing_Base_Bearing_Locking_Ring:1 ↔ ISO 7380-1 M4 x 40:6
- Mate:20: 3DP_PLA_A_Axis_Bearing_Base_Bearing_Locking_Ring:1 ↔ ISO 7380-1 M4 x 40:7
- Mate:21: 3DP_PLA_A_Axis_Bearing_Base_Bearing_Locking_Ring:1 ↔ ISO 7380-1 M4 x 40:7
- Mate:22: 3DP_PLA_A_Axis_Bearing_Base_Bearing_Locking_Ring:1 ↔ ISO 7380-1 M4 x 40:8
- Mate:23: 3DP_PLA_A_Axis_Bearing_Base_Bearing_Locking_Ring:1 ↔ ISO 7380-1 M4 x 40:8
- Mate:24: 3DP_PLA_A_Axis_Bearing_Base_Bearing_Locking_Ring:1 ↔ DIN 934 - replaced by DIN EN 24032/28673/28674 M4:1
- Mate:25: 3DP_PLA_A_Axis_Bearing_Base:1 ↔ DIN 934 - replaced by DIN EN 24032/28673/28674 M4:1
- Mate:26: 3DP_PLA_A_Axis_Bearing_Base_Bearing_Locking_Ring:1 ↔ DIN 934 - replaced by DIN EN 24032/28673/28674 M4:2
- Mate:27: 3DP_PLA_A_Axis_Bearing_Base:1 ↔ DIN 934 - replaced by DIN EN 24032/28673/28674 M4:2
- Mate:28: 3DP_PLA_A_Axis_Bearing_Base_Bearing_Locking_Ring:1 ↔ DIN 934 - replaced by DIN EN 24032/28673/28674 M4:3
- Mate:29: 3DP_PLA_A_Axis_Bearing_Base:1 ↔ DIN 934 - replaced by DIN EN 24032/28673/28674 M4:3
- Mate:30: 3DP_PLA_A_Axis_Bearing_Base_Bearing_Locking_Ring:1 ↔ DIN 934 - replaced by DIN EN 24032/28673/28674 M4:4
- Mate:31: 3DP_PLA_A_Axis_Bearing_Base:1 ↔ DIN 934 - replaced by DIN EN 24032/28673/28674 M4:4
- Mate:32: 3DP_PLA_A_Axis_Bearing_Base_Bearing_Locking_Ring:1 ↔ DIN 934 - replaced by DIN EN 24032/28673/28674 M4:5
- Mate:33: 3DP_PLA_A_Axis_Bearing_Base:1 ↔ DIN 934 - replaced by DIN EN 24032/28673/28674 M4:5
- Mate:34: 3DP_PLA_A_Axis_Bearing_Base_Bearing_Locking_Ring:1 ↔ DIN 934 - replaced by DIN EN 24032/28673/28674 M4:6
- Mate:35: 3DP_PLA_A_Axis_Bearing_Base:1 ↔ DIN 934 - replaced by DIN EN 24032/28673/28674 M4:6
- Mate:36: 3DP_PLA_A_Axis_Bearing_Base_Bearing_Locking_Ring:1 ↔ DIN 934 - replaced by DIN EN 24032/28673/28674 M4:7
- Mate:37: 3DP_PLA_A_Axis_Bearing_Base:1 ↔ DIN 934 - replaced by DIN EN 24032/28673/28674 M4:7
- Mate:38: 3DP_PLA_A_Axis_Bearing_Base_Bearing_Locking_Ring:1 ↔ DIN 934 - replaced by DIN EN 24032/28673/28674 M4:8
- Mate:39: 3DP_PLA_A_Axis_Bearing_Base:1 ↔ DIN 934 - replaced by DIN EN 24032/28673/28674 M4:8
- Angle:1 (0 deg): 3DP_PLA_A_Axis_Bearing_Base:1 ↔ DIN 934 - replaced by DIN EN 24032/28673/28674 M4:2
- Angle:2 (0 deg): 3DP_PLA_A_Axis_Bearing_Base:1 ↔ DIN 934 - replaced by DIN EN 24032/28673/28674 M4:3
- Angle:3 (0 deg): 3DP_PLA_A_Axis_Bearing_Base:1 ↔ DIN 934 - replaced by DIN EN 24032/28673/28674 M4:4
- Angle:4 (0 deg): 3DP_PLA_A_Axis_Bearing_Base:1 ↔ DIN 934 - replaced by DIN EN 24032/28673/28674 M4:5
- Angle:5 (0 deg): 3DP_PLA_A_Axis_Bearing_Base:1 ↔ DIN 934 - replaced by DIN EN 24032/28673/28674 M4:6
- Angle:6 (0 deg): 3DP_PLA_A_Axis_Bearing_Base:1 ↔ DIN 934 - replaced by DIN EN 24032/28673/28674 M4:7
- Angle:7 (0 deg): 3DP_PLA_A_Axis_Bearing_Base:1 ↔ DIN 934 - replaced by DIN EN 24032/28673/28674 M4:8
- Angle:8 (0 deg): 3DP_PLA_A_Axis_Bearing_Base:1 ↔ DIN 934 - replaced by DIN EN 24032/28673/28674 M4:1
- Mate:40: COTS_GENERIC_6020_2RS_150x100x24mm_Ball_Bearing:1 ↔ 3DP_PLA_A_Axis_Rotating_Stage:1
- Mate:41: COTS_GENERIC_6020_2RS_150x100x24mm_Ball_Bearing:1 ↔ 3DP_PLA_A_Axis_Rotating_Stage:1
- Mate:42: COTS_GENERIC_6020_2RS_150x100x24mm_Ball_Bearing:1 ↔ 3DP_PLA_A_Axis_Rotating_Stage_Mounting_Plate:1
- Mate:43: COTS_GENERIC_6020_2RS_150x100x24mm_Ball_Bearing:1 ↔ 3DP_PLA_A_Axis_Rotating_Stage_Mounting_Plate:1
- Mate:44: 3DP_PLA_A_Axis_Rotating_Stage:1 ↔ 3DP_PLA_A_Axis_Rotating_Stage_Mounting_Plate:1
- Mate:45: 3DP_PLA_A_Axis_Rotating_Stage:1 ↔ DIN 912 - replaced by DIN EN ISO 4762 M5 x 50:1
- Mate:46: 3DP_PLA_A_Axis_Rotating_Stage:1 ↔ DIN 912 - replaced by DIN EN ISO 4762 M5 x 50:1
- Mate:47: 3DP_PLA_A_Axis_Rotating_Stage:1 ↔ DIN 912 - replaced by DIN EN ISO 4762 M5 x 50:2
- Mate:48: 3DP_PLA_A_Axis_Rotating_Stage:1 ↔ DIN 912 - replaced by DIN EN ISO 4762 M5 x 50:2
- Mate:49: 3DP_PLA_A_Axis_Rotating_Stage:1 ↔ DIN 912 - replaced by DIN EN ISO 4762 M5 x 50:3
- Mate:50: 3DP_PLA_A_Axis_Rotating_Stage:1 ↔ DIN 912 - replaced by DIN EN ISO 4762 M5 x 50:3
- Mate:51: 3DP_PLA_A_Axis_Rotating_Stage:1 ↔ DIN 912 - replaced by DIN EN ISO 4762 M5 x 50:4
- Mate:52: 3DP_PLA_A_Axis_Rotating_Stage:1 ↔ DIN 912 - replaced by DIN EN ISO 4762 M5 x 50:4
- Mate:53: 3DP_PLA_A_Axis_Rotating_Stage:1 ↔ DIN 912 - replaced by DIN EN ISO 4762 M5 x 50:5
- Mate:54: 3DP_PLA_A_Axis_Rotating_Stage:1 ↔ DIN 912 - replaced by DIN EN ISO 4762 M5 x 50:5
- Mate:55: 3DP_PLA_A_Axis_Rotating_Stage:1 ↔ DIN 912 - replaced by DIN EN ISO 4762 M5 x 50:6
- Mate:56: 3DP_PLA_A_Axis_Rotating_Stage:1 ↔ DIN 912 - replaced by DIN EN ISO 4762 M5 x 50:6
- Mate:57: 3DP_PLA_A_Axis_Rotating_Stage:1 ↔ DIN 912 - replaced by DIN EN ISO 4762 M5 x 50:7
- Mate:58: 3DP_PLA_A_Axis_Rotating_Stage:1 ↔ DIN 912 - replaced by DIN EN ISO 4762 M5 x 50:7
- Mate:59: 3DP_PLA_A_Axis_Rotating_Stage:1 ↔ DIN 912 - replaced by DIN EN ISO 4762 M5 x 50:8
- Mate:60: 3DP_PLA_A_Axis_Rotating_Stage:1 ↔ DIN 912 - replaced by DIN EN ISO 4762 M5 x 50:8
- Mate:61: 3DP_PLA_A_Axis_Rotating_Stage:1 ↔ DIN 934 - replaced by DIN EN 24032/28673/28674 M5:1
- Mate:62: 3DP_PLA_A_Axis_Rotating_Stage_Mounting_Plate:1 ↔ DIN 934 - replaced by DIN EN 24032/28673/28674 M5:1
- Mate:63: 3DP_PLA_A_Axis_Rotating_Stage:1 ↔ DIN 934 - replaced by DIN EN 24032/28673/28674 M5:2
- Mate:64: 3DP_PLA_A_Axis_Rotating_Stage_Mounting_Plate:1 ↔ DIN 934 - replaced by DIN EN 24032/28673/28674 M5:2
- Mate:65: 3DP_PLA_A_Axis_Rotating_Stage:1 ↔ DIN 934 - replaced by DIN EN 24032/28673/28674 M5:3
- Mate:66: 3DP_PLA_A_Axis_Rotating_Stage_Mounting_Plate:1 ↔ DIN 934 - replaced by DIN EN 24032/28673/28674 M5:3
- Mate:67: 3DP_PLA_A_Axis_Rotating_Stage:1 ↔ DIN 934 - replaced by DIN EN 24032/28673/28674 M5:4
- Mate:68: 3DP_PLA_A_Axis_Rotating_Stage_Mounting_Plate:1 ↔ DIN 934 - replaced by DIN EN 24032/28673/28674 M5:4
- Mate:69: 3DP_PLA_A_Axis_Rotating_Stage:1 ↔ DIN 934 - replaced by DIN EN 24032/28673/28674 M5:5
- Mate:70: 3DP_PLA_A_Axis_Rotating_Stage_Mounting_Plate:1 ↔ DIN 934 - replaced by DIN EN 24032/28673/28674 M5:5
- Mate:71: 3DP_PLA_A_Axis_Rotating_Stage:1 ↔ DIN 934 - replaced by DIN EN 24032/28673/28674 M5:6
- Mate:72: 3DP_PLA_A_Axis_Rotating_Stage_Mounting_Plate:1 ↔ DIN 934 - replaced by DIN EN 24032/28673/28674 M5:6
- Mate:73: 3DP_PLA_A_Axis_Rotating_Stage:1 ↔ DIN 934 - replaced by DIN EN 24032/28673/28674 M5:7
- Mate:74: 3DP_PLA_A_Axis_Rotating_Stage_Mounting_Plate:1 ↔ DIN 934 - replaced by DIN EN 24032/28673/28674 M5:7
- Mate:75: 3DP_PLA_A_Axis_Rotating_Stage:1 ↔ DIN 934 - replaced by DIN EN 24032/28673/28674 M5:8
- Mate:76: 3DP_PLA_A_Axis_Rotating_Stage_Mounting_Plate:1 ↔ DIN 934 - replaced by DIN EN 24032/28673/28674 M5:8
- Angle:9 (0 deg): 3DP_PLA_A_Axis_Rotating_Stage_Mounting_Plate:1 ↔ DIN 934 - replaced by DIN EN 24032/28673/28674 M5:2
- Angle:10 (0 deg): 3DP_PLA_A_Axis_Rotating_Stage_Mounting_Plate:1 ↔ DIN 934 - replaced by DIN EN 24032/28673/28674 M5:3
- Angle:11 (0 deg): 3DP_PLA_A_Axis_Rotating_Stage_Mounting_Plate:1 ↔ DIN 934 - replaced by DIN EN 24032/28673/28674 M5:4
- Angle:12 (0 deg): 3DP_PLA_A_Axis_Rotating_Stage_Mounting_Plate:1 ↔ DIN 934 - replaced by DIN EN 24032/28673/28674 M5:5
- Angle:13 (0 deg): 3DP_PLA_A_Axis_Rotating_Stage_Mounting_Plate:1 ↔ DIN 934 - replaced by DIN EN 24032/28673/28674 M5:6
- Angle:14 (0 deg): 3DP_PLA_A_Axis_Rotating_Stage_Mounting_Plate:1 ↔ DIN 934 - replaced by DIN EN 24032/28673/28674 M5:7
- Angle:15 (0 deg): 3DP_PLA_A_Axis_Rotating_Stage_Mounting_Plate:1 ↔ DIN 934 - replaced by DIN EN 24032/28673/28674 M5:8
- Angle:16 (0 deg): 3DP_PLA_A_Axis_Rotating_Stage_Mounting_Plate:1 ↔ DIN 934 - replaced by DIN EN 24032/28673/28674 M5:1
- Mate:77: COTS_MKS_SERVO42D_40mm:1 ↔ COTS_GENERIC_HTD3M_24T_6mm_5mm_shaft_pulley:1
- Mate:78: 3DP_PLA_A_Axis_Rotating_Stage:1 ↔ COTS_GENERIC_HTD3M_6mm_675mm_Closed_belt_A_Axis:1
- Mate:79 (0.5 mm): 3DP_PLA_A_Axis_Rotating_Stage:1 ↔ COTS_GENERIC_HTD3M_6mm_675mm_Closed_belt_A_Axis:1
- Angle:17 (0 deg): 3DP_PLA_A_Axis_Bearing_Base:1
- Mate:80: 3DP_PLA_A_Axis_Bearing_Base:1 ↔ 3DP_PLA_A_Axis_Stepper_Mount_REVB:1
- Mate:81: 3DP_PLA_A_Axis_Bearing_Base:1 ↔ 3DP_PLA_A_Axis_Stepper_Mount_REVB:1
- Mate:82: 3DP_PLA_A_Axis_Bearing_Base:1 ↔ 3DP_PLA_A_Axis_Stepper_Mount_REVB:1
- Mate:83: 3DP_PLA_A_Axis_Stepper_Mount_REVB:1 ↔ ISO 7380-1 M4 x 40:9
- Mate:84: 3DP_PLA_A_Axis_Stepper_Mount_REVB:1 ↔ ISO 7380-1 M4 x 40:9
- Mate:85: 3DP_PLA_A_Axis_Stepper_Mount_REVB:1 ↔ ISO 7380-1 M4 x 40:10
- Mate:86: 3DP_PLA_A_Axis_Stepper_Mount_REVB:1 ↔ ISO 7380-1 M4 x 40:10
- Mate:87: 3DP_PLA_A_Axis_Stepper_Mount_REVB:1 ↔ ISO 7380-1 M4 x 40:11
- Mate:88: 3DP_PLA_A_Axis_Stepper_Mount_REVB:1 ↔ ISO 7380-1 M4 x 40:11
- Mate:89: 3DP_PLA_A_Axis_Stepper_Mount_REVB:1 ↔ DIN 934 - replaced by DIN EN 24032/28673/28674 M4:9
- Mate:90: 3DP_PLA_A_Axis_Bearing_Base:1 ↔ DIN 934 - replaced by DIN EN 24032/28673/28674 M4:9